# Autodesk Inventor assembly: 101013 DH-16-B1
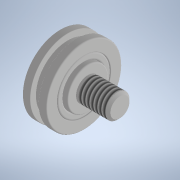
[picture p0: Inventor's stored thumbnail of the model, 180x180]
Saved by Autodesk Inventor 2021 (Build 250183000, 183)
## iProperties
Category: PARTsolutions
Company: TOKBEARING
Created: 2025-04-11
Part Number: 101013 DH-16-B1
Catalog Web Link: www.cadenas.de
Description: DH-A,B,H-
Vendor: TOKBEARING
Document SubType Name: Assembly
Designer: psAdmin
Manufacturer: TOKBEARING
Mass: 106200 g
Surface Area: 22.658 cm^2
Volume: 1.67677 cm^3
Density: 63335.9 g/cm^3
Title: 101013 DH-16-B1
Author: Cadenas PARTsolutions
PSOL_IDENT_0: {$CADENAS_DATA/23d-libs/tok_bearing/d_series_bearings/dh_abh_asmtab.prj},179 {VTYP=3D},{STYP=ASSTAB}
PSOL_IDENT_1: ,{NB=101013 DH-16-B1},{LINA=101013 DH-16-B1},{NN=DH-A,B,H},{DATE=24.03.2025 06:05:05},{GEOMDATE=25.1
PSOL_IDENT_2: 2.2012},{VERSION=},{LINEID=2630},{WBVAR=},{WBNUMERIC=}  {NB=101013 DH-16-B1},{LINA=101013 DH-16-B1},
PSOL_IDENT_3: {KT=DUMMY},{IDNR=},{CODE=101013},{PN=DH-16-B1},{D=19},{D1=16.0},{SD=-},{SDX=0.000},{SD1=-},{SD1X=0.0
PSOL_IDENT_4: 00},{W=6},{C=1},{CX=1.000},{L=8},{LX=8.000},{D2XT=-},{D2=0.000},{T=0.000},{G=2.1},{TYPE=2},{QTY=2.00
PSOL_IDENT_5: 0},{GW=11.8},{NDM=6.000},{BD=3},{OP=39.878},{N=6},{R=6.35},{GP=2.82},{PPATH=dh_abh/dh_abh_asmtpl.prj
PSOL_IDENT_6: }
NB: 101013 DH-16-B1
NN: DH-A,B,H
NBSYN: $CODE. $PN.
LINA: 101013 DH-16-B1
CATALOG: TOK, Inc
CODE: 101013
PN: DH-16-B1
D: 19
D1: 16
SD: -
SD1: -
W: 6
C: 1
L: 8
D2XT: -
G: 2.1
TYPE: 2
QTY: 2.000
GW: 11.8
SUPPLIER: TOKBEARING
ARTICLENO: 101013 DH-16-B1
BOMINFO: 101013 DH-16-B1
CREATOR: CADENAS GmbH
## Documents named in this file (5)
- e:\temp\worker_COMMON_42\temp\tmp_6500_44_AluCW\format_0\101013 DH-16-B1.iam
- e:\temp\worker_COMMON_42\temp\tmp_6500_44_AluCW\format_0\101013DH-16-B1_ir.ipt
- e:\temp\worker_COMMON_42\temp\tmp_6500_44_AluCW\format_0\101013DH-16-B1_or.ipt
- e:\temp\worker_COMMON_42\temp\tmp_6500_44_AluCW\format_0\101013DH-16-B1_cage.ipt
- e:\temp\worker_COMMON_42\temp\tmp_6500_44_AluCW\format_0\101013DH-16-B1_ball.ipt
## Components (9 placed, 4 different names)
1. 101013DH-16-B1_ir:1 — IR_OR_XY@1 <-> IR_OR_XY@2, IR_OR_Z@1 <-> IR_OR_Z@2
2. 101013DH-16-B1_or:1 — IR_OR_XY@1 <-> IR_OR_XY@2, IR_OR_Z@1 <-> IR_OR_Z@2, OR_Cage_XY@2 <-> Cage_OR_XY@3, OR_Cage_Z@2 <-> Cage_OR_Z@3, OR_Cage_YZ@2 <-> Cage_OR_YZ@3
3. 101013DH-16-B1_cage:1 — OR_Cage_XY@2 <-> Cage_OR_XY@3, OR_Cage_Z@2 <-> Cage_OR_Z@3, OR_Cage_YZ@2 <-> Cage_OR_YZ@3, Cage_Ball_1_XY@3 <-> Ball_Cage_XY@4, Cage_Ball_1_Z@3 <-> Ball_Cage_Z@4, Cage_Ball_1_YZ@3 <-> Ball_Cage_YZ@4, Cage_Ball_2_XY@3 <-> Ball_Cage_XY@5, Cage_Ball_2_Z@3 <-> Ball_Cage_Z@5, Cage_Ball_2_YZ@3 <-> Ball_Cage_YZ@5, Cage_Ball_3_XY@3 <-> Ball_Cage_XY@6, Cage_Ball_3_Z@3 <-> Ball_Cage_Z@6, Cage_Ball_3_YZ@3 <-> Ball_Cage_YZ@6, Cage_Ball_4_XY@3 <-> Ball_Cage_XY@7, Cage_Ball_4_Z@3 <-> Ball_Cage_Z@7, Cage_Ball_4_YZ@3 <-> Ball_Cage_YZ@7, Cage_Ball_5_XY@3 <-> Ball_Cage_XY@8, Cage_Ball_5_Z@3 <-> Ball_Cage_Z@8, Cage_Ball_5_YZ@3 <-> Ball_Cage_YZ@8, Cage_Ball_6_XY@3 <-> Ball_Cage_XY@9, Cage_Ball_6_Z@3 <-> Ball_Cage_Z@9, Cage_Ball_6_YZ@3 <-> Ball_Cage_YZ@9
4. 101013DH-16-B1_ball:1 — Cage_Ball_1_XY@3 <-> Ball_Cage_XY@4, Cage_Ball_1_Z@3 <-> Ball_Cage_Z@4, Cage_Ball_1_YZ@3 <-> Ball_Cage_YZ@4
5. 101013DH-16-B1_ball:2 — Cage_Ball_2_XY@3 <-> Ball_Cage_XY@5, Cage_Ball_2_Z@3 <-> Ball_Cage_Z@5, Cage_Ball_2_YZ@3 <-> Ball_Cage_YZ@5
6. 101013DH-16-B1_ball:3 — Cage_Ball_3_XY@3 <-> Ball_Cage_XY@6, Cage_Ball_3_Z@3 <-> Ball_Cage_Z@6, Cage_Ball_3_YZ@3 <-> Ball_Cage_YZ@6
7. 101013DH-16-B1_ball:4 — Cage_Ball_4_XY@3 <-> Ball_Cage_XY@7, Cage_Ball_4_Z@3 <-> Ball_Cage_Z@7, Cage_Ball_4_YZ@3 <-> Ball_Cage_YZ@7
8. 101013DH-16-B1_ball:5 — Cage_Ball_5_XY@3 <-> Ball_Cage_XY@8, Cage_Ball_5_Z@3 <-> Ball_Cage_Z@8, Cage_Ball_5_YZ@3 <-> Ball_Cage_YZ@8
9. 101013DH-16-B1_ball:6 — Cage_Ball_6_XY@3 <-> Ball_Cage_XY@9, Cage_Ball_6_Z@3 <-> Ball_Cage_Z@9, Cage_Ball_6_YZ@3 <-> Ball_Cage_YZ@9
## Relationships (23: Mate 14, Angle 7, Flush 2)
- IR_OR_XY@1 <-> IR_OR_XY@2 [Flush]: 101013DH-16-B1_ir:1 ↔ 101013DH-16-B1_or:1
- IR_OR_Z@1 <-> IR_OR_Z@2 [Mate]: 101013DH-16-B1_ir:1 ↔ 101013DH-16-B1_or:1
- OR_Cage_XY@2 <-> Cage_OR_XY@3 [Flush]: 101013DH-16-B1_or:1 ↔ 101013DH-16-B1_cage:1
- OR_Cage_Z@2 <-> Cage_OR_Z@3 [Mate]: 101013DH-16-B1_or:1 ↔ 101013DH-16-B1_cage:1
- OR_Cage_YZ@2 <-> Cage_OR_YZ@3 [Angle] (0 deg): 101013DH-16-B1_or:1 ↔ 101013DH-16-B1_cage:1
- Cage_Ball_1_XY@3 <-> Ball_Cage_XY@4 [Mate]: 101013DH-16-B1_cage:1 ↔ 101013DH-16-B1_ball:1
- Cage_Ball_1_Z@3 <-> Ball_Cage_Z@4 [Mate]: 101013DH-16-B1_cage:1 ↔ 101013DH-16-B1_ball:1
- Cage_Ball_1_YZ@3 <-> Ball_Cage_YZ@4 [Angle] (0 deg): 101013DH-16-B1_cage:1 ↔ 101013DH-16-B1_ball:1
- Cage_Ball_2_XY@3 <-> Ball_Cage_XY@5 [Mate]: 101013DH-16-B1_cage:1 ↔ 101013DH-16-B1_ball:2
- Cage_Ball_2_Z@3 <-> Ball_Cage_Z@5 [Mate]: 101013DH-16-B1_cage:1 ↔ 101013DH-16-B1_ball:2
- Cage_Ball_2_YZ@3 <-> Ball_Cage_YZ@5 [Angle] (0 deg): 101013DH-16-B1_cage:1 ↔ 101013DH-16-B1_ball:2
- Cage_Ball_3_XY@3 <-> Ball_Cage_XY@6 [Mate]: 101013DH-16-B1_cage:1 ↔ 101013DH-16-B1_ball:3
- Cage_Ball_3_Z@3 <-> Ball_Cage_Z@6 [Mate]: 101013DH-16-B1_cage:1 ↔ 101013DH-16-B1_ball:3
- Cage_Ball_3_YZ@3 <-> Ball_Cage_YZ@6 [Angle] (0 deg): 101013DH-16-B1_cage:1 ↔ 101013DH-16-B1_ball:3
- Cage_Ball_4_XY@3 <-> Ball_Cage_XY@7 [Mate]: 101013DH-16-B1_cage:1 ↔ 101013DH-16-B1_ball:4
- Cage_Ball_4_Z@3 <-> Ball_Cage_Z@7 [Mate]: 101013DH-16-B1_cage:1 ↔ 101013DH-16-B1_ball:4
- Cage_Ball_4_YZ@3 <-> Ball_Cage_YZ@7 [Angle] (0 deg): 101013DH-16-B1_cage:1 ↔ 101013DH-16-B1_ball:4
- Cage_Ball_5_XY@3 <-> Ball_Cage_XY@8 [Mate]: 101013DH-16-B1_cage:1 ↔ 101013DH-16-B1_ball:5
- Cage_Ball_5_Z@3 <-> Ball_Cage_Z@8 [Mate]: 101013DH-16-B1_cage:1 ↔ 101013DH-16-B1_ball:5
- Cage_Ball_5_YZ@3 <-> Ball_Cage_YZ@8 [Angle] (0 deg): 101013DH-16-B1_cage:1 ↔ 101013DH-16-B1_ball:5
- Cage_Ball_6_XY@3 <-> Ball_Cage_XY@9 [Mate]: 101013DH-16-B1_cage:1 ↔ 101013DH-16-B1_ball:6
- Cage_Ball_6_Z@3 <-> Ball_Cage_Z@9 [Mate]: 101013DH-16-B1_cage:1 ↔ 101013DH-16-B1_ball:6
- Cage_Ball_6_YZ@3 <-> Ball_Cage_YZ@9 [Angle] (0 deg): 101013DH-16-B1_cage:1 ↔ 101013DH-16-B1_ball:6
